# Autodesk Inventor assembly: MM0937AN200_G03_817
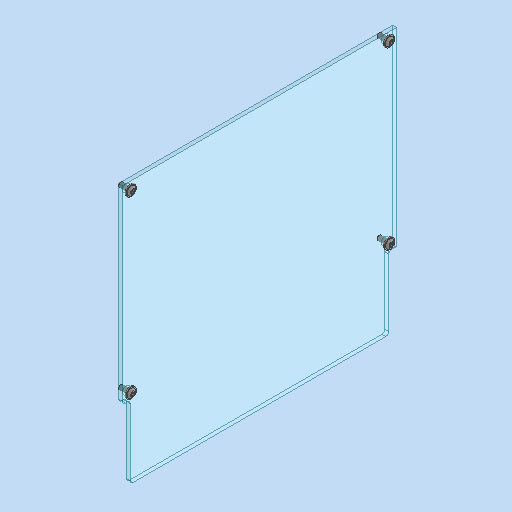
[picture p0: Inventor's stored thumbnail of the model, 512x512]
Saved by Autodesk Inventor 2023.3 (Build 273359000, 359)
## iProperties
RuleStatus: InUse
Created: 2023-03-15
Part Number: MM0937AN200_G03_817
Description: =<RBPARTNOTITLE2>
Document SubType Name: Assembly
Designer: ric7an
Mass: 372.65 g
Surface Area: 1570.79 cm^2
Volume: 302.58 cm^3
Density: 1.23158 g/cm^3
AnP_Material: =<Material>
AnP_TemplVers: 20200821
RBDOCUMENTTYPE: DRF
RBDOCUMENTVERSION: 00
RBDRAWINGMAINSCALE: 1:1
RBDRAWINGMISSINGSPEC: --
RBDRAWINGVOLUME: --
RBDSV1: 0850
RBGBEDGESIN1: +0,5
RBGBEDGESIN2: +0,2
RBGBEDGESOUT1: -0,3
RBGBEDGESOUT2: -0,1
RBMATERIAL: =<Material>
RBMATMEETS: --
RBMATNO: =<Part Number>
RBPARTMADEOF: --
RBPARTNO: SIEHE MNR
RBPARTNOTITLE1: --
RBPARTSAFETYINDICATOR: --
RBSURFACE: --
RBSURFACE2: --
RBZEDGESNORM: ISO13715:2002-06
RBZGENDIMCLASS: m
RBZGENDIMNORM: ISO 2768-1:1989-11
RBZGENGEOCLASS: H
RBZGENGEONORM: ISO 2768-2:1989-11
RBZSURFACENORM: ISO13D2:2002-02
RBZTOLERANCENORM: ISO 14405-1:2010-12
Author: ric7an
Keywords: =<RBPARTMADEOF>
Comments: =<RBSURFACE2>
Revision Number: 01
## Documents named in this file (3)
- C:\Users\rea9an\Documents\Inventor\TCAI2412_te1910_EM\AS00000917.iam
- C:\Users\rea9an\Documents\Inventor\TCAI2412_te1910_EM\PT00004803.ipt
- C:\Users\rea9an\Documents\Inventor\TCAI2412_te1910_EM\PT00004389.ipt
## Components (5 placed, 2 different names)
1. PT00004803:1
2. PT00004389:1
3. PT00004389:2
4. PT00004389:3
5. PT00004389:4
## Relationships (4: Insert 4)
- [Insert]: PT00004803:1 ↔ PT00004389:1
- [Insert]: PT00004803:1 ↔ PT00004389:3
- [Insert]: PT00004803:1 ↔ PT00004389:4
- [Insert]: PT00004803:1 ↔ PT00004389:2
